# Autodesk Inventor assembly: inner-belt1
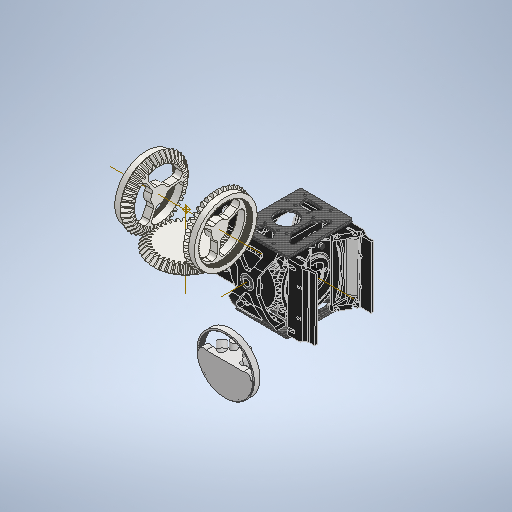
[picture p0: Inventor's stored thumbnail of the model, 512x512]
Saved by Autodesk Inventor 2025.3 (Build 293356030, 356C)
## iProperties
Created: 2026-03-02
Part Number: inner-belt1
Document SubType Name: Assembly
Designer: ibuki_ono
Author: ibuki_ono
## Documents named in this file (6)
- C:\Users\ibuki_ono\Documents\hobby\rogiken\catchrobo\2026_CAD\Hardware_2026\Inventor\belt\inner-belt1.iam
- C:\Users\ibuki_ono\Documents\hobby\rogiken\catchrobo\2026_CAD\Hardware_2026\Inventor\belt\3D_belt-inner.ipt
- C:\Users\ibuki_ono\Documents\hobby\rogiken\catchrobo\2026_CAD\Hardware_2026\Inventor\belt\3D_belt-MXL-100-num.ipt
- C:\Users\ibuki_ono\Documents\hobby\rogiken\catchrobo\CAD\Hardware_CAD\Inventor\hand\hand.iam
- C:\Users\ibuki_ono\Documents\hobby\rogiken\catchrobo\2026_CAD\Hardware_2026\Inventor\belt\unbrella\ub-40-p2.ipt
- C:\Users\ibuki_ono\Documents\hobby\rogiken\catchrobo\2026_CAD\Hardware_2026\Inventor\belt\unbrella\ub-40-p2-original.ipt
## Components (6 placed, 4 different names)
1. 3D_belt-inner:1 — メイト:1, メイト:2
2. 3D_belt-MXL-100-num:1 — メイト:1, メイト:2
3. hand:1 [sub-assembly]
4. かさ歯車2:1 — メイト:4, メイト:6
5. かさ歯車2:2 — メイト:3, メイト:7
6. かさ歯車2:3 — メイト:5, メイト:6, メイト:7
## Relationships (7: Mate 7)
- メイト:1 [Mate]: 3D_belt-inner:1 ↔ 3D_belt-MXL-100-num:1
- メイト:2 [Mate]: 3D_belt-inner:1 ↔ 3D_belt-MXL-100-num:1
- メイト:3 [Mate]: かさ歯車2:2
- メイト:4 [Mate]: かさ歯車2:1
- メイト:5 [Mate]: かさ歯車2:3
- メイト:6 [Mate]: かさ歯車2:1 ↔ かさ歯車2:3
- メイト:7 [Mate]: かさ歯車2:2 ↔ かさ歯車2:3
